# Autodesk Inventor assembly: Calço motor Pittman
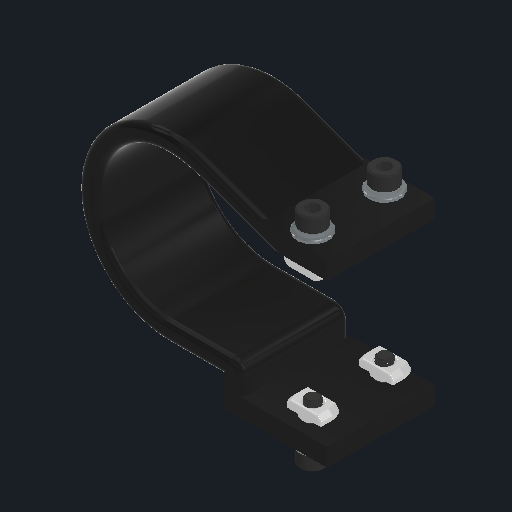
[picture p0: Inventor's stored thumbnail of the model, 512x512]
Saved by Autodesk Inventor 2026.1 (Build 301233000, 233)
## iProperties
Created: 2025-01-15
Part Number: Calço motor Pittman
Document SubType Name: Assembly
Designer: Cliente
Mass: 37.2182 g
Surface Area: 150.978 cm^2
Volume: 26.1282 cm^3
Density: 1.42444 g/cm^3
Author: Cliente
## Documents named in this file (6)
- C:\Users\Cliente\Desktop\TCC\Base\Motor\Calço motor Pittman.iam
- C:\Users\Cliente\Desktop\TCC\Base\Impresso\Calço motor Pittman.ipt
- C:\Users\Cliente\Desktop\TCC\Fixação\Porca martelo M4 canal 6.ipt
- C:\Users\Cliente\Desktop\TCC\Fixação\Arruela Lisa DIN 125 - B4 - 300 HV.ipt
- C:\Users\Cliente\Desktop\TCC\Fixação\Arruela de Pressão DIN 127 - B4.ipt
- C:\Users\Cliente\Desktop\TCC\Fixação\Parafuso Allen Cabeça Cilíndrica DIN 912 - M4 - 12.9.ipt
## Components (17 placed, 5 different names)
1. Calço motor Pittman:1 — Alinhado:1, Alinhado:2, Alinhado:3, Coincidente:26, Ângulo:13, Coincidente:28, Ângulo:15, Coincidente:31, Coincidente:32, Coincidente:33, Coincidente:34, Coincidente:35, Coincidente:36, Coincidente:37, Coincidente:38, Coincidente:39, Coincidente:40, Coincidente:41, Coincidente:42, Coincidente:43, Coincidente:44
2. Porca martelo M4 canal 6:1 — Ângulo:16, Coincidente:32, Coincidente:35
3. Porca martelo M4 canal 6:2 — Ângulo:15, Ângulo:16, Coincidente:31, Coincidente:36
4. Porca martelo M4 canal 6:3 — Ângulo:14, Coincidente:28, Coincidente:33
5. Porca martelo M4 canal 6:4 — Coincidente:26, Ângulo:13, Ângulo:14, Coincidente:34
6. Arruela Lisa DIN 125 - B4 - 300 HV:1 — Coincidente:37, Coincidente:44, Ângulo:17, Coincidente:45, Coincidente:52
7. Arruela Lisa DIN 125 - B4 - 300 HV:2 — Coincidente:38, Coincidente:43, Ângulo:18, Coincidente:46, Coincidente:51
8. Arruela Lisa DIN 125 - B4 - 300 HV:3 — Coincidente:39, Coincidente:42, Ângulo:19, Coincidente:47, Coincidente:49
9. Arruela Lisa DIN 125 - B4 - 300 HV:4 — Coincidente:40, Coincidente:41, Ângulo:20, Coincidente:48, Coincidente:50
10. Arruela de Pressão DIN 127 - B4:1 — Coincidente:45, Coincidente:52, Ângulo:21, Coincidente:53, Coincidente:57
11. Arruela de Pressão DIN 127 - B4:2 — Coincidente:46, Coincidente:51, Ângulo:22, Coincidente:54, Coincidente:58
12. Arruela de Pressão DIN 127 - B4:3 — Coincidente:47, Coincidente:49, Ângulo:23, Coincidente:55, Coincidente:60
13. Arruela de Pressão DIN 127 - B4:4 — Coincidente:48, Coincidente:50, Ângulo:24, Coincidente:56, Coincidente:59
14. Parafuso Allen Cabeça Cilíndrica DIN 912 - M4 - 12.9:1 — Coincidente:53, Coincidente:57, Ângulo:25
15. Parafuso Allen Cabeça Cilíndrica DIN 912 - M4 - 12.9:2 — Coincidente:54, Coincidente:58, Ângulo:26
16. Parafuso Allen Cabeça Cilíndrica DIN 912 - M4 - 12.9:3 — Coincidente:55, Coincidente:60, Ângulo:27
17. Parafuso Allen Cabeça Cilíndrica DIN 912 - M4 - 12.9:4 — Coincidente:56, Coincidente:59, Ângulo:28
## Relationships (51: Mate 32, Angle 16, Flush 3)
- Alinhado:1 [Flush]: Calço motor Pittman:1
- Alinhado:2 [Flush]: Calço motor Pittman:1
- Alinhado:3 [Flush]: Calço motor Pittman:1
- Coincidente:26 [Mate] (1.8 mm): Calço motor Pittman:1 ↔ Porca martelo M4 canal 6:4
- Ângulo:13 [Angle] (0 deg): Calço motor Pittman:1 ↔ Porca martelo M4 canal 6:4
- Ângulo:14 [Angle] (0 deg): Porca martelo M4 canal 6:3 ↔ Porca martelo M4 canal 6:4
- Coincidente:28 [Mate] (1.8 mm): Calço motor Pittman:1 ↔ Porca martelo M4 canal 6:3
- Ângulo:15 [Angle] (0 deg): Calço motor Pittman:1 ↔ Porca martelo M4 canal 6:2
- Ângulo:16 [Angle] (0 deg): Porca martelo M4 canal 6:1 ↔ Porca martelo M4 canal 6:2
- Coincidente:31 [Mate] (1.8 mm): Calço motor Pittman:1 ↔ Porca martelo M4 canal 6:2
- Coincidente:32 [Mate] (1.8 mm): Calço motor Pittman:1 ↔ Porca martelo M4 canal 6:1
- Coincidente:33 [Mate]: Calço motor Pittman:1 ↔ Porca martelo M4 canal 6:3
- Coincidente:34 [Mate]: Calço motor Pittman:1 ↔ Porca martelo M4 canal 6:4
- Coincidente:35 [Mate]: Calço motor Pittman:1 ↔ Porca martelo M4 canal 6:1
- Coincidente:36 [Mate]: Calço motor Pittman:1 ↔ Porca martelo M4 canal 6:2
- Coincidente:37 [Mate]: Calço motor Pittman:1 ↔ Arruela Lisa DIN 125 - B4 - 300 HV:1
- Coincidente:38 [Mate]: Calço motor Pittman:1 ↔ Arruela Lisa DIN 125 - B4 - 300 HV:2
- Coincidente:39 [Mate]: Calço motor Pittman:1 ↔ Arruela Lisa DIN 125 - B4 - 300 HV:3
- Coincidente:40 [Mate]: Calço motor Pittman:1 ↔ Arruela Lisa DIN 125 - B4 - 300 HV:4
- Coincidente:41 [Mate]: Calço motor Pittman:1 ↔ Arruela Lisa DIN 125 - B4 - 300 HV:4
- Coincidente:42 [Mate]: Calço motor Pittman:1 ↔ Arruela Lisa DIN 125 - B4 - 300 HV:3
- Coincidente:43 [Mate]: Calço motor Pittman:1 ↔ Arruela Lisa DIN 125 - B4 - 300 HV:2
- Coincidente:44 [Mate]: Calço motor Pittman:1 ↔ Arruela Lisa DIN 125 - B4 - 300 HV:1
- Ângulo:17 [Angle] (0 deg): Arruela Lisa DIN 125 - B4 - 300 HV:1
- Ângulo:18 [Angle] (0 deg): Arruela Lisa DIN 125 - B4 - 300 HV:2
- Ângulo:19 [Angle] (0 deg): Arruela Lisa DIN 125 - B4 - 300 HV:3
- Ângulo:20 [Angle] (0 deg): Arruela Lisa DIN 125 - B4 - 300 HV:4
- Coincidente:45 [Mate]: Arruela Lisa DIN 125 - B4 - 300 HV:1 ↔ Arruela de Pressão DIN 127 - B4:1
- Coincidente:46 [Mate]: Arruela Lisa DIN 125 - B4 - 300 HV:2 ↔ Arruela de Pressão DIN 127 - B4:2
- Coincidente:47 [Mate]: Arruela Lisa DIN 125 - B4 - 300 HV:3 ↔ Arruela de Pressão DIN 127 - B4:3
- Coincidente:48 [Mate]: Arruela Lisa DIN 125 - B4 - 300 HV:4 ↔ Arruela de Pressão DIN 127 - B4:4
- Coincidente:49 [Mate]: Arruela Lisa DIN 125 - B4 - 300 HV:3 ↔ Arruela de Pressão DIN 127 - B4:3
- Coincidente:50 [Mate]: Arruela Lisa DIN 125 - B4 - 300 HV:4 ↔ Arruela de Pressão DIN 127 - B4:4
- Coincidente:51 [Mate]: Arruela Lisa DIN 125 - B4 - 300 HV:2 ↔ Arruela de Pressão DIN 127 - B4:2
- Coincidente:52 [Mate]: Arruela Lisa DIN 125 - B4 - 300 HV:1 ↔ Arruela de Pressão DIN 127 - B4:1
- Ângulo:21 [Angle] (0 deg): Arruela de Pressão DIN 127 - B4:1
- Ângulo:22 [Angle] (0 deg): Arruela de Pressão DIN 127 - B4:2
- Ângulo:23 [Angle] (0 deg): Arruela de Pressão DIN 127 - B4:3
- Ângulo:24 [Angle] (0 deg): Arruela de Pressão DIN 127 - B4:4
- Coincidente:53 [Mate]: Arruela de Pressão DIN 127 - B4:1 ↔ Parafuso Allen Cabeça Cilíndrica DIN 912 - M4 - 12.9:1
- Coincidente:54 [Mate]: Arruela de Pressão DIN 127 - B4:2 ↔ Parafuso Allen Cabeça Cilíndrica DIN 912 - M4 - 12.9:2
- Coincidente:55 [Mate]: Arruela de Pressão DIN 127 - B4:3 ↔ Parafuso Allen Cabeça Cilíndrica DIN 912 - M4 - 12.9:3
- Coincidente:56 [Mate]: Arruela de Pressão DIN 127 - B4:4 ↔ Parafuso Allen Cabeça Cilíndrica DIN 912 - M4 - 12.9:4
- Coincidente:57 [Mate]: Arruela de Pressão DIN 127 - B4:1 ↔ Parafuso Allen Cabeça Cilíndrica DIN 912 - M4 - 12.9:1
- Coincidente:58 [Mate]: Arruela de Pressão DIN 127 - B4:2 ↔ Parafuso Allen Cabeça Cilíndrica DIN 912 - M4 - 12.9:2
- Coincidente:59 [Mate]: Arruela de Pressão DIN 127 - B4:4 ↔ Parafuso Allen Cabeça Cilíndrica DIN 912 - M4 - 12.9:4
- Coincidente:60 [Mate]: Arruela de Pressão DIN 127 - B4:3 ↔ Parafuso Allen Cabeça Cilíndrica DIN 912 - M4 - 12.9:3
- Ângulo:25 [Angle] (0 deg): Parafuso Allen Cabeça Cilíndrica DIN 912 - M4 - 12.9:1
- Ângulo:26 [Angle] (0 deg): Parafuso Allen Cabeça Cilíndrica DIN 912 - M4 - 12.9:2
- Ângulo:27 [Angle] (0 deg): Parafuso Allen Cabeça Cilíndrica DIN 912 - M4 - 12.9:3
- Ângulo:28 [Angle] (0 deg): Parafuso Allen Cabeça Cilíndrica DIN 912 - M4 - 12.9:4
